# Autodesk Inventor assembly: Calf_Link_Right_Assembly
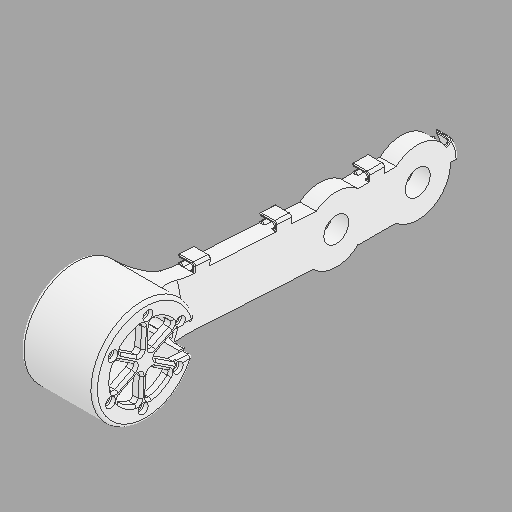
[picture p0: Inventor's stored thumbnail of the model, 512x512]
Saved by Autodesk Inventor 2025 (Build 290162000, 162)
## iProperties
Created: 2024-11-14
Part Number: Calf_Link_Right_Assembly
Document SubType Name: Assembly
Designer: OSB
Mass: 338.238 g
Surface Area: 708.148 cm^2
Volume: 171.477 cm^3
Density: 1.9725 g/cm^3
Sending System: Autodesk Inventor 2021
Preprocessor: unknown
Minimum Resolution: 0.01
Sent Units: Millimeter
Translation Standard: IGES 5.3
Model Creation Time: 2020-07-07
Title: S500 Frame
Author: OSB
## Documents named in this file (4)
- C:\Users\OSB\Desktop\SB\1.Projects\캡스톤 디자인(2)_Paper\Modeling\Implementation_Design\Ver_003_mass_update\Calf_Link_Right_Assembly_Collision.iam
- C:\Users\OSB\Desktop\SB\1.Projects\캡스톤 디자인(2)_Paper\Modeling\Implementation_Design\Ver_003_mass_update\Calf_Link_Right.ipt
- C:\Users\OSB\Desktop\SB\1.Projects\캡스톤 디자인(2)_Paper\Modeling\Implementation_Design\Ver_003_mass_update\Servo_Wheel_MG4010E_i10.ipt
- C:\Users\OSB\Documents\Inventor\Content Center Files\R2025\ko-KR\KS B 1003\KS B 1003 - M 3 x 10.ipt
## Components (8 placed, 3 different names)
1. Calf_Link_Right:1 — 회전:1, 메이트:1, 삽입:1, 삽입:2, 삽입:3, 삽입:4, 삽입:5, 삽입:6
2. Servo_Wheel_MG4010E_i10:1 — 회전:1, 메이트:1
3. KS B 1003 - 미터 M 3 x 10:1 — 삽입:1
4. KS B 1003 - 미터 M 3 x 10:2 — 삽입:2
5. KS B 1003 - 미터 M 3 x 10:3 — 삽입:3
6. KS B 1003 - 미터 M 3 x 10:4 — 삽입:4
7. KS B 1003 - 미터 M 3 x 10:5 — 삽입:5
8. KS B 1003 - 미터 M 3 x 10:6 — 삽입:6
## Relationships (8: Insert 6, RevoluteJoint 1, Mate 1)
- 회전:1 [RevoluteJoint]: Calf_Link_Right:1 ↔ Servo_Wheel_MG4010E_i10:1
- 메이트:1 [Mate]: Calf_Link_Right:1 ↔ Servo_Wheel_MG4010E_i10:1
- 삽입:1 [Insert]: Calf_Link_Right:1 ↔ KS B 1003 - 미터 M 3 x 10:1
- 삽입:2 [Insert]: Calf_Link_Right:1 ↔ KS B 1003 - 미터 M 3 x 10:2
- 삽입:3 [Insert]: Calf_Link_Right:1 ↔ KS B 1003 - 미터 M 3 x 10:3
- 삽입:4 [Insert]: Calf_Link_Right:1 ↔ KS B 1003 - 미터 M 3 x 10:4
- 삽입:5 [Insert]: Calf_Link_Right:1 ↔ KS B 1003 - 미터 M 3 x 10:5
- 삽입:6 [Insert]: Calf_Link_Right:1 ↔ KS B 1003 - 미터 M 3 x 10:6
